# Autodesk Inventor assembly: Assembly1_stp
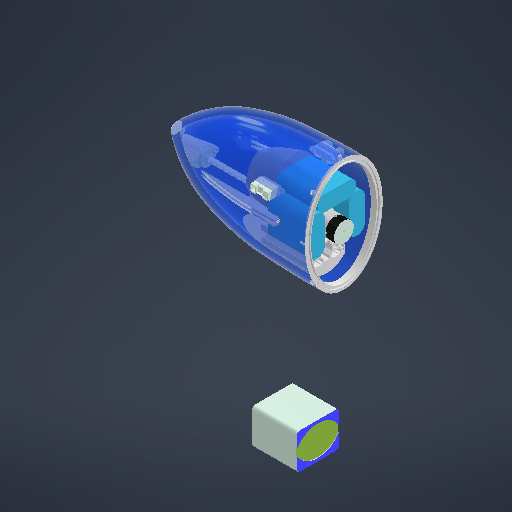
[picture p0: Inventor's stored thumbnail of the model, 512x512]
Saved by Autodesk Inventor 2027 (Build 310192060, 192F)
## iProperties
Created: 2026-07-18
Part Number: Assembly1_stp
Document SubType Name: Assembly
Designer: thita
Sending System: SIEMENS PLM Software NX 12.0
Preprocessor: ST-DEVELOPER v16.7
Title: Assembly1_stp.stp
## Documents named in this file (14)
- D:\Year2\đồ án tốt nghịp\1\Workgroups\NotInProject\Assembly1_stp.iam
- D:\Year2\đồ án tốt nghịp\1\Workgroups\NotInProject\DAU.ipt
- D:\Year2\đồ án tốt nghịp\1\Workgroups\NotInProject\GP2Y0A02YK0F SHARP.ipt
- D:\Year2\đồ án tốt nghịp\1\Workgroups\NotInProject\Khối pin sạc Li-ion 12V 21Ah 30A 3S MTM.ipt
- D:\Year2\đồ án tốt nghịp\1\Workgroups\NotInProject\5mm to 8mm rigid shaft coupler v2.ipt
- D:\Year2\đồ án tốt nghịp\1\Workgroups\NotInProject\vitme-t8-buoc2.ipt
- D:\Year2\đồ án tốt nghịp\1\Workgroups\NotInProject\JGB37-520.ipt
- D:\Year2\đồ án tốt nghịp\1\Workgroups\NotInProject\Document.ipt
- D:\Year2\đồ án tốt nghịp\1\Workgroups\NotInProject\MIENG SAT DE DO.ipt
- D:\Year2\đồ án tốt nghịp\1\Workgroups\NotInProject\Ta bang inox.ipt
- D:\Year2\đồ án tốt nghịp\1\Workgroups\NotInProject\nut housing T8.ipt
- D:\Year2\đồ án tốt nghịp\1\Workgroups\NotInProject\JGB37-520 12 v metal geared motor bracket.ipt
- D:\Year2\đồ án tốt nghịp\1\Workgroups\NotInProject\3060 Aluminum Extrusion Profile.ipt
- D:\Year2\đồ án tốt nghịp\1\Workgroups\NotInProject\pin sạc 12V 2.6Ah 25A.ipt
## Components (16 placed, 14 different names)
1. DAU_1001
2. GP2Y0A02YK0F SHARP_1002
3. GP2Y0A02YK0F SHARP_1003
4. Khối pin sạc Li-ion 12V 21Ah 30A 3S MTM_1004
5. 5mm to 8mm rigid shaft coupler v2_1008
6. vitme-t8-buoc2_1009 — Mate:1, Mate:2
7. JGB37-520_1010 — Mate:3, Mate:4
8. Document_1011
9. MIENG SAT DE DO_1012 — Mate:5, Rigid:1
10. Ta bang inox_1013 — Rigid:1
11. nut housing T8_1014 — Mate:1, Mate:2, Mate:5
12. JGB37-520 12 v metal geared motor bracket:2 — Mate:3, Mate:4
13. 3060 Aluminum Extrusion Profile:1
14. pin sạc 12V 2.6Ah 25A:1
15. pin sạc 12V 2.6Ah 25A:2
16. pin sạc 12V 2.6Ah 25A:3
## Relationships (6: Mate 5, WeldJoint 1)
- Mate:1: vitme-t8-buoc2_1009 ↔ nut housing T8_1014
- Mate:2: vitme-t8-buoc2_1009 ↔ nut housing T8_1014
- Mate:3: JGB37-520_1010 ↔ JGB37-520 12 v metal geared motor bracket:2
- Mate:4: JGB37-520_1010 ↔ JGB37-520 12 v metal geared motor bracket:2
- Mate:5: MIENG SAT DE DO_1012 ↔ nut housing T8_1014
- Rigid:1 [WeldJoint]: MIENG SAT DE DO_1012 ↔ Ta bang inox_1013
## Named parameters: Finish1_Area = 2007.8
note: some values were not read from the file. Shown as the stored number, unit unknown: "Finish1_Area".
